# Autodesk Inventor assembly: Ensamblaje1
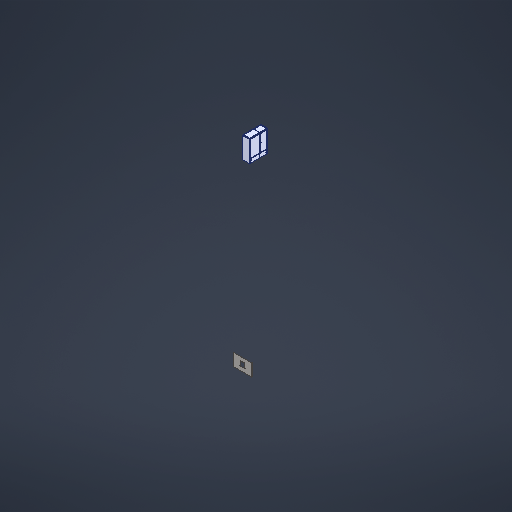
[picture p0: Inventor's stored thumbnail of the model, 512x512]
Saved by Autodesk Inventor 2027 (Build 310192000, 192)
## iProperties
Created: 2026-10-07
Part Number: Ensamblaje1
Document SubType Name: Assembly
Designer: aaron_orrantia
Author: aaron_orrantia
## Documents named in this file (12)
- C:\Users\aaron_orrantia\OneDrive - grupoarga.com\Escritorio\VANTRAN 02-10-2026\VANTRAN 261503\06-70-1605 Compartment\Ensamblaje1.iam
- C:\Users\aaron_orrantia\OneDrive - grupoarga.com\Escritorio\VANTRAN 02-10-2026\VANTRAN 261503\06-70-1605 Compartment\06-70-1605 Compartment\261503_Comp-Compartment Cover\261503_Comp-Compartment Cover.ipt
- C:\Users\aaron_orrantia\OneDrive - grupoarga.com\Escritorio\VANTRAN 02-10-2026\VANTRAN 261503\06-70-1605 Compartment\06-70-1605 Compartment\261503_Comp-Front Sill Top\261503_Comp-Front Sill Top.ipt
- C:\Users\aaron_orrantia\OneDrive - grupoarga.com\Escritorio\VANTRAN 02-10-2026\VANTRAN 261503\06-70-1605 Compartment\06-70-1605 Compartment\261503_Comp-Left Door\261503_Comp-Left Door.ipt
- C:\Users\aaron_orrantia\OneDrive - grupoarga.com\Escritorio\VANTRAN 02-10-2026\VANTRAN 261503\06-70-1605 Compartment\06-70-1605 Compartment\261503_Comp-Left Side\261503_Comp-Left Side.ipt
- C:\Users\aaron_orrantia\OneDrive - grupoarga.com\Escritorio\VANTRAN 02-10-2026\VANTRAN 261503\06-70-1605 Compartment\06-70-1605 Compartment\261503_Comp-Rear Brace Bottom\261503_Comp-Rear Brace Bottom.ipt
- C:\Users\aaron_orrantia\OneDrive - grupoarga.com\Escritorio\VANTRAN 02-10-2026\VANTRAN 261503\06-70-1605 Compartment\06-70-1605 Compartment\261503_Comp-Rear Brace Top\261503_Comp-Rear Brace Top.ipt
- C:\Users\aaron_orrantia\OneDrive - grupoarga.com\Escritorio\VANTRAN 02-10-2026\VANTRAN 261503\06-70-1605 Compartment\06-70-1605 Compartment\261503_Comp-Right Door\261503_Comp-Right Door.ipt
- C:\Users\aaron_orrantia\OneDrive - grupoarga.com\Escritorio\VANTRAN 02-10-2026\VANTRAN 261503\06-70-1605 Compartment\06-70-1605 Compartment\261503_Comp-Right Side\261503_Comp-Right Side.ipt
- C:\Users\aaron_orrantia\OneDrive - grupoarga.com\Escritorio\VANTRAN 02-10-2026\VANTRAN 261503\06-70-1605 Compartment\06-70-1605 Compartment\Comp-Front Sill Bottom\Comp-Front Sill Bottom.ipt
- C:\Users\aaron_orrantia\OneDrive - grupoarga.com\Escritorio\VANTRAN 02-10-2026\VANTRAN 261503\06-70-1605 Compartment\06-70-1605 Compartment\261503_Comp-Center Barrier\261503_Comp-Center Barrier.ipt
- C:\Users\aaron_orrantia\OneDrive - grupoarga.com\Escritorio\VANTRAN 02-10-2026\VANTRAN 261503\06-70-1605 Compartment\TANKCOVER.ipt
## Components (11 placed, 11 different names)
1. 261503_Comp-Compartment Cover:1 — Coincidencia:13, Coincidencia:14, Coincidencia:15
2. 261503_Comp-Front Sill Top:1 — Coincidencia:10, Nivelación:7, Nivelación:8, Coincidencia:15
3. 261503_Comp-Left Door:1 — Coincidencia:2, Nivelación:2, Coincidencia:4, Coincidencia:11, Nivelación:11
4. 261503_Comp-Left Side:1 — Coincidencia:2, Nivelación:1, Nivelación:2, Coincidencia:6, Coincidencia:7, Coincidencia:8, Nivelación:8, Coincidencia:13, Coincidencia:14, Nivelación:9, Nivelación:10, Coincidencia:16
5. 261503_Comp-Rear Brace Bottom:1 — Nivelación:9, Nivelación:10, Coincidencia:16
6. 261503_Comp-Rear Brace Top:1 — Coincidencia:7, Coincidencia:8, Nivelación:6, Coincidencia:12
7. 261503_Comp-Right Door:1 — Coincidencia:1, Nivelación:3, Coincidencia:3
8. 261503_Comp-Right Side:1 — Coincidencia:1, Nivelación:1, Nivelación:3, Nivelación:4, Coincidencia:5, Nivelación:5, Nivelación:6, Coincidencia:10, Nivelación:7
9. Comp-Front Sill Bottom:1 — Coincidencia:3, Coincidencia:4, Nivelación:4, Coincidencia:5, Nivelación:5, Coincidencia:6
10. 261503_Comp-Center Barrier:1 — Coincidencia:11, Coincidencia:12, Nivelación:11
11. TANKCOVER:1
## Relationships (26: Mate 15, Flush 11)
- Coincidencia:1 [Mate]: 261503_Comp-Right Door:1 ↔ 261503_Comp-Right Side:1
- Coincidencia:2 [Mate]: 261503_Comp-Left Door:1 ↔ 261503_Comp-Left Side:1
- Nivelación:1 [Flush]: 261503_Comp-Left Side:1 ↔ 261503_Comp-Right Side:1
- Nivelación:2 [Flush]: 261503_Comp-Left Door:1 ↔ 261503_Comp-Left Side:1
- Nivelación:3 [Flush]: 261503_Comp-Right Door:1 ↔ 261503_Comp-Right Side:1
- Coincidencia:3 [Mate]: 261503_Comp-Right Door:1 ↔ Comp-Front Sill Bottom:1
- Coincidencia:4 [Mate]: 261503_Comp-Left Door:1 ↔ Comp-Front Sill Bottom:1
- Nivelación:4 [Flush]: 261503_Comp-Right Side:1 ↔ Comp-Front Sill Bottom:1
- Coincidencia:5 [Mate]: 261503_Comp-Right Side:1 ↔ Comp-Front Sill Bottom:1
- Nivelación:5 [Flush]: 261503_Comp-Right Side:1 ↔ Comp-Front Sill Bottom:1
- Coincidencia:6 [Mate]: 261503_Comp-Left Side:1 ↔ Comp-Front Sill Bottom:1
- Coincidencia:7 [Mate]: 261503_Comp-Left Side:1 ↔ 261503_Comp-Rear Brace Top:1
- Coincidencia:8 [Mate]: 261503_Comp-Left Side:1 ↔ 261503_Comp-Rear Brace Top:1
- Nivelación:6 [Flush]: 261503_Comp-Rear Brace Top:1 ↔ 261503_Comp-Right Side:1
- Coincidencia:10 [Mate]: 261503_Comp-Front Sill Top:1 ↔ 261503_Comp-Right Side:1
- Nivelación:7 [Flush]: 261503_Comp-Front Sill Top:1 ↔ 261503_Comp-Right Side:1
- Nivelación:8 [Flush]: 261503_Comp-Front Sill Top:1 ↔ 261503_Comp-Left Side:1
- Coincidencia:11 [Mate]: 261503_Comp-Left Door:1 ↔ 261503_Comp-Center Barrier:1
- Coincidencia:12 [Mate]: 261503_Comp-Rear Brace Top:1 ↔ 261503_Comp-Center Barrier:1
- Coincidencia:13 [Mate]: 261503_Comp-Compartment Cover:1 ↔ 261503_Comp-Left Side:1
- Coincidencia:14 [Mate]: 261503_Comp-Compartment Cover:1 ↔ 261503_Comp-Left Side:1
- Coincidencia:15 [Mate]: 261503_Comp-Compartment Cover:1 ↔ 261503_Comp-Front Sill Top:1
- Nivelación:9 [Flush]: 261503_Comp-Left Side:1 ↔ 261503_Comp-Rear Brace Bottom:1
- Nivelación:10 [Flush]: 261503_Comp-Left Side:1 ↔ 261503_Comp-Rear Brace Bottom:1
- Coincidencia:16 [Mate]: 261503_Comp-Left Side:1 ↔ 261503_Comp-Rear Brace Bottom:1
- Nivelación:11 [Flush]: 261503_Comp-Left Door:1 ↔ 261503_Comp-Center Barrier:1
